# Autodesk Inventor assembly: ensamblaje base
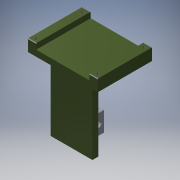
[picture p0: Inventor's stored thumbnail of the model, 180x180]
Saved by Autodesk Inventor 2017 (Build 210142000, 142)
## iProperties
Part Number: ensamblaje base
Material: Genérico
Document SubType Name: Assembly
Designer: HP Pav
Author: HP Pav
## Documents named in this file (6)
- C:\Users\HP Pav\Desktop\diseño 2º dfm\matriz corte\ensamblaje base.iam
- C:\Users\HP Pav\Desktop\diseño 2º dfm\matriz corte\base.ipt
- C:\Users\HP Pav\Desktop\diseño 2º dfm\matriz corte\largueros.ipt
- C:\Users\HP Pav\Desktop\diseño 2º dfm\matriz corte\soporte vertical.ipt
- C:\Users\HP Pav\Desktop\diseño 2º dfm\matriz corte\pieza soldada a vertical.ipt
- C:\Users\HP Pav\Desktop\diseño 2º dfm\matriz corte\nucleo eje.ipt
## Components (5 placed, 5 different names)
1. base:1 — Nivelación:1, Nivelación:2, Nivelación:3
2. largueros:1 — Nivelación:1
3. soporte vertical:1 — Nivelación:2, Nivelación:3, Nivelación:4, Nivelación:5
4. pieza soldada a vertical:1 — Nivelación:4, Nivelación:5, Nivelación:6, Nivelación:7
5. nucleo eje:1 — Nivelación:6, Nivelación:7
## Relationships (7: Flush 7)
- Nivelación:1 [Flush]: base:1 ↔ largueros:1
- Nivelación:2 [Flush]: base:1 ↔ soporte vertical:1
- Nivelación:3 [Flush]: base:1 ↔ soporte vertical:1
- Nivelación:4 [Flush]: soporte vertical:1 ↔ pieza soldada a vertical:1
- Nivelación:5 [Flush]: soporte vertical:1 ↔ pieza soldada a vertical:1
- Nivelación:6 [Flush]: pieza soldada a vertical:1 ↔ nucleo eje:1
- Nivelación:7 [Flush]: pieza soldada a vertical:1 ↔ nucleo eje:1
